# Autodesk Inventor assembly: knee_gui_E50_M50_C50
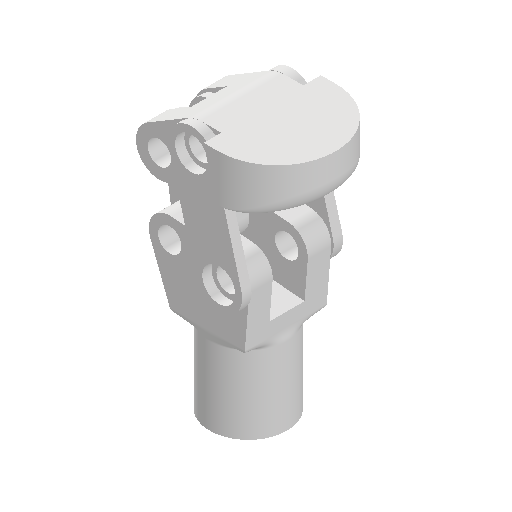
[picture p0: Inventor's stored thumbnail of the model, 512x512]
Saved by Autodesk Inventor 2026.1 (Build 301233020, 233B)
## iProperties
Created: 2025-11-26
Part Number: knee_gui_E50_M50_C50
Document SubType Name: Assembly
Designer: matia
Author: matia
## Documents named in this file (5)
- C:\protesis_rodilla_usfq_software\knee-prosthesis-designer\results\knee_gui_E50_M50_C50\knee_gui_E50_M50_C50.iam
- C:\protesis_rodilla_usfq_software\knee-prosthesis-designer\results\knee_gui_E50_M50_C50\bar_dc.ipt
- C:\protesis_rodilla_usfq_software\knee-prosthesis-designer\results\knee_gui_E50_M50_C50\bar_ab.ipt
- C:\protesis_rodilla_usfq_software\knee-prosthesis-designer\results\knee_gui_E50_M50_C50\base_ad.ipt
- C:\protesis_rodilla_usfq_software\knee-prosthesis-designer\results\knee_gui_E50_M50_C50\bar_bc.ipt
## Components (5 placed, 4 different names)
1. bar_dc:3 — Mate:1, Mate:2, Mate:9
2. bar_ab:1 — Mate:5, Mate:6, Mate:7, Mate:8
3. bar_dc:4 — Mate:3, Mate:4, Mate:10
4. base_ad:1 — Mate:1, Mate:2, Mate:3, Mate:4, Mate:5, Mate:6
5. bar_bc:1 — Mate:7, Mate:8, Mate:9, Mate:10, Angle:1
## Relationships (11: Mate 10, Angle 1)
- Mate:1: bar_dc:3 ↔ base_ad:1
- Mate:2: bar_dc:3 ↔ base_ad:1
- Mate:3: bar_dc:4 ↔ base_ad:1
- Mate:4: bar_dc:4 ↔ base_ad:1
- Mate:5: bar_ab:1 ↔ base_ad:1
- Mate:6: bar_ab:1 ↔ base_ad:1
- Mate:7: bar_ab:1 ↔ bar_bc:1
- Mate:8: bar_ab:1 ↔ bar_bc:1
- Mate:9: bar_dc:3 ↔ bar_bc:1
- Mate:10: bar_dc:4 ↔ bar_bc:1
- Angle:1 (-90 deg): bar_bc:1
